# Autodesk Inventor assembly: RDS-GHN500-1000 Container
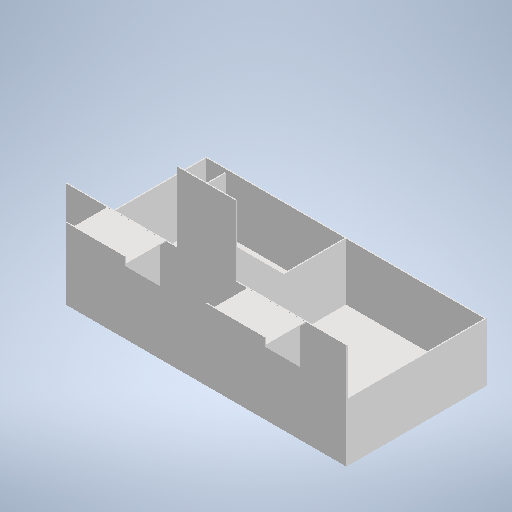
[picture p0: Inventor's stored thumbnail of the model, 512x512]
Saved by Autodesk Inventor 2026 (Build 300175000, 175)
## iProperties
Created: 2026-10-27
Part Number: RDS-GHN500-1000 Container
Document SubType Name: Assembly
Designer: user
Author: user
## Documents named in this file (8)
- C:\Users\user\Documents\Inventor\RDS-Reagent-Dosing-Station\RDS-GHN500-0000 Reagent Dosing Station\RDS-GHN500-1000 Container .iam
- C:\Users\user\Documents\Inventor\RDS-Reagent-Dosing-Station\RDS-GHN500 Reagent Dosing Station\RDS-GHN500-1000 Container.ipt
- C:\Users\user\Documents\Inventor\RDS-Reagent-Dosing-Station\RDS-GHN500 Reagent Dosing Station\RDS-GHN500-1001 Container shelf.ipt
- C:\Users\user\Documents\Inventor\RDS-Reagent-Dosing-Station\RDS-GHN500 Reagent Dosing Station\RDS-GHN500-1001 Container shelf2.ipt
- C:\Users\user\Documents\Inventor\RDS-Reagent-Dosing-Station\RDS-GHN500 Reagent Dosing Station\RDS-GHN500-1002 Container shelf rib.ipt
- C:\Users\user\Documents\Inventor\RDS-Reagent-Dosing-Station\RDS-GHN500 Reagent Dosing Station\RDS-GHN500-1002 Container shelf rib2.ipt
- C:\Users\user\Documents\Inventor\RDS-Reagent-Dosing-Station\RDS-GHN500 Reagent Dosing Station\RDS-GHN500-1002 Container shelf rib3.ipt
- C:\Users\user\Documents\Inventor\RDS-Reagent-Dosing-Station\RDS-GHN500 Reagent Dosing Station\RDS-GHN500-1002 Container shelf rib4.ipt
## Components (7 placed, 7 different names)
1. RDS-GHN500-1000 Container:1 — Заподлицо:1, Совмещение:1, Заподлицо:2, Заподлицо:3, Совмещение:2, Заподлицо:4, Совмещение:3, Совмещение:6, Совмещение:7, Совмещение:9
2. RDS-GHN500-1001 Container shelf:1 — Заподлицо:1, Совмещение:1, Заподлицо:2, Заподлицо:7, Совмещение:8, Заподлицо:8, Совмещение:10
3. RDS-GHN500-1001 Container shelf22:1 — Заподлицо:3, Совмещение:2, Заподлицо:4, Заподлицо:5, Совмещение:4, Заподлицо:6, Совмещение:5
4. RDS-GHN500-1002 Container shelf rib:1 — Заподлицо:5, Совмещение:3, Совмещение:4
5. RDS-GHN500-1002 Container shelf rib2:1 — Заподлицо:6, Совмещение:5, Совмещение:6
6. RDS-GHN500-1002 Container shelf rib3:1 — Заподлицо:7, Совмещение:7, Совмещение:8
7. RDS-GHN500-1002 Container shelf rib4:1 — Заподлицо:8, Совмещение:9, Совмещение:10
## Relationships (18: Mate 10, Flush 8)
- Заподлицо:1 [Flush]: RDS-GHN500-1000 Container:1 ↔ RDS-GHN500-1001 Container shelf:1
- Совмещение:1 [Mate]: RDS-GHN500-1000 Container:1 ↔ RDS-GHN500-1001 Container shelf:1
- Заподлицо:2 [Flush] (350 mm): RDS-GHN500-1000 Container:1 ↔ RDS-GHN500-1001 Container shelf:1
- Заподлицо:3 [Flush]: RDS-GHN500-1000 Container:1 ↔ RDS-GHN500-1001 Container shelf22:1
- Совмещение:2 [Mate]: RDS-GHN500-1000 Container:1 ↔ RDS-GHN500-1001 Container shelf22:1
- Заподлицо:4 [Flush] (350 mm): RDS-GHN500-1000 Container:1 ↔ RDS-GHN500-1001 Container shelf22:1
- Заподлицо:5 [Flush] (50 mm): RDS-GHN500-1001 Container shelf22:1 ↔ RDS-GHN500-1002 Container shelf rib:1
- Совмещение:3 [Mate]: RDS-GHN500-1000 Container:1 ↔ RDS-GHN500-1002 Container shelf rib:1
- Совмещение:4 [Mate]: RDS-GHN500-1001 Container shelf22:1 ↔ RDS-GHN500-1002 Container shelf rib:1
- Заподлицо:6 [Flush] (50 mm): RDS-GHN500-1001 Container shelf22:1 ↔ RDS-GHN500-1002 Container shelf rib2:1
- Совмещение:5 [Mate]: RDS-GHN500-1001 Container shelf22:1 ↔ RDS-GHN500-1002 Container shelf rib2:1
- Совмещение:6 [Mate]: RDS-GHN500-1000 Container:1 ↔ RDS-GHN500-1002 Container shelf rib2:1
- Заподлицо:7 [Flush] (50 mm): RDS-GHN500-1001 Container shelf:1 ↔ RDS-GHN500-1002 Container shelf rib3:1
- Совмещение:7 [Mate]: RDS-GHN500-1000 Container:1 ↔ RDS-GHN500-1002 Container shelf rib3:1
- Совмещение:8 [Mate]: RDS-GHN500-1001 Container shelf:1 ↔ RDS-GHN500-1002 Container shelf rib3:1
- Заподлицо:8 [Flush] (50 mm): RDS-GHN500-1001 Container shelf:1 ↔ RDS-GHN500-1002 Container shelf rib4:1
- Совмещение:9 [Mate]: RDS-GHN500-1000 Container:1 ↔ RDS-GHN500-1002 Container shelf rib4:1
- Совмещение:10 [Mate]: RDS-GHN500-1001 Container shelf:1 ↔ RDS-GHN500-1002 Container shelf rib4:1
